# Autodesk Inventor assembly: XM430-W350-R
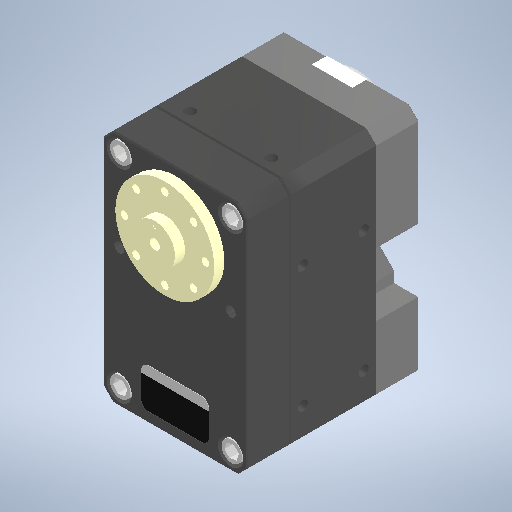
[picture p0: Inventor's stored thumbnail of the model, 512x512]
Saved by Autodesk Inventor 2025.2 (Build 292293000, 293)
## iProperties
Created: 2018-07-05
Part Number: XM430-W350-R
Document SubType Name: Assembly
Designer: ricoa
Title: /vol/tmp/translate-329079067709669955/5b3e80553a1eeb103c565669.step
Revision Number: NONE
## Documents named in this file (17)
- C:\Users\ricoa\OneDrive\Desktop\PROYEK AKHIR\project_pororo\XM430-W350-R\XM430-W350-R\XM430-W350-R.iam
- C:\Users\ricoa\OneDrive\Desktop\PROYEK AKHIR\project_pororo\XM430-W350-R\XM430-W350-R\Part 1.ipt
- C:\Users\ricoa\OneDrive\Desktop\PROYEK AKHIR\project_pororo\XM430-W350-R\XM430-W350-R\Part 2.ipt
- C:\Users\ricoa\OneDrive\Desktop\PROYEK AKHIR\project_pororo\XM430-W350-R\XM430-W350-R\Part 3.ipt
- C:\Users\ricoa\OneDrive\Desktop\PROYEK AKHIR\project_pororo\XM430-W350-R\XM430-W350-R\Part 4.ipt
- C:\Users\ricoa\OneDrive\Desktop\PROYEK AKHIR\project_pororo\XM430-W350-R\XM430-W350-R\Part 5.ipt
- C:\Users\ricoa\OneDrive\Desktop\PROYEK AKHIR\project_pororo\XM430-W350-R\XM430-W350-R\Part 6.ipt
- C:\Users\ricoa\OneDrive\Desktop\PROYEK AKHIR\project_pororo\XM430-W350-R\XM430-W350-R\Part 7.ipt
- C:\Users\ricoa\OneDrive\Desktop\PROYEK AKHIR\project_pororo\XM430-W350-R\XM430-W350-R\Part 8.ipt
- C:\Users\ricoa\OneDrive\Desktop\PROYEK AKHIR\project_pororo\XM430-W350-R\XM430-W350-R\Part 9.ipt
- C:\Users\ricoa\OneDrive\Desktop\PROYEK AKHIR\project_pororo\XM430-W350-R\XM430-W350-R\Part 10.ipt
- C:\Users\ricoa\OneDrive\Desktop\PROYEK AKHIR\project_pororo\XM430-W350-R\XM430-W350-R\Part 11.ipt
- C:\Users\ricoa\OneDrive\Desktop\PROYEK AKHIR\project_pororo\XM430-W350-R\XM430-W350-R\Part 12.ipt
- C:\Users\ricoa\OneDrive\Desktop\PROYEK AKHIR\project_pororo\XM430-W350-R\XM430-W350-R\Part 13.ipt
- C:\Users\ricoa\OneDrive\Desktop\PROYEK AKHIR\project_pororo\XM430-W350-R\XM430-W350-R\Part 14.ipt
- C:\Users\ricoa\OneDrive\Desktop\PROYEK AKHIR\project_pororo\XM430-W350-R\XM430-W350-R\Part 15.ipt
- C:\Users\ricoa\OneDrive\Desktop\PROYEK AKHIR\project_pororo\XM430-W350-R\XM430-W350-R\Part 16.ipt
## Components (16 placed, 16 different names)
1. NAUO1 — Mate:1, Mate:2
2. NAUO2
3. NAUO3
4. NAUO4 — Mate:1, Mate:2
5. NAUO5
6. NAUO6
7. NAUO7
8. NAUO8
9. NAUO9
10. NAUO10
11. NAUO11
12. NAUO12
13. NAUO13
14. NAUO14
15. NAUO15
16. NAUO16
## Relationships (2: Mate 2)
- Mate:1: NAUO1 ↔ NAUO4
- Mate:2: NAUO1 ↔ NAUO4
